# Autodesk Inventor assembly: MM0861AN105_G12_001
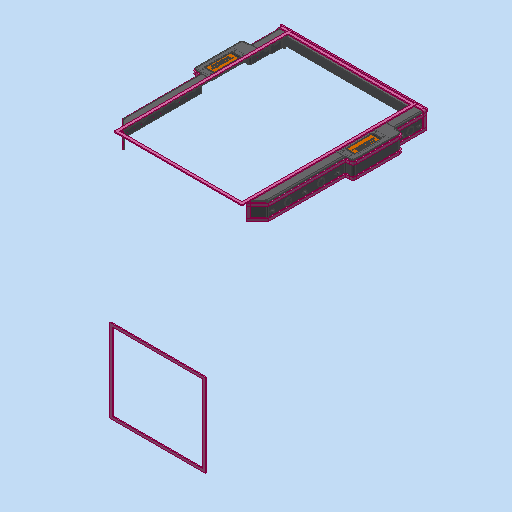
[picture p0: Inventor's stored thumbnail of the model, 512x512]
Saved by Autodesk Inventor 2023.3 (Build 273359000, 359)
## iProperties
Part Number: MM0861AN105_G12_001
Material: Generisch
Description: =<RBPARTNOTITLE2>
Document SubType Name: Assembly
Designer: ric7an
Mass: 4497.53 g
Surface Area: 6763.95 cm^2
Volume: 875.397 cm^3
Density: 5.1377 g/cm^3
RBCHANGEDESCRIPTION1: Erstfreigabe
RBCHANGENO1: 00
RBDOCUMENTTYPE: DRF
RBDOCUMENTVERSION: 00
RBDRAWINGMAINSCALE: 1:1
RBDRAWINGMISSINGSPEC: --
RBDRAWINGVOLUME: --
RBDSV1: 0850
RBGBDETAILS: 43274
RBGBEDGESIN1: +0,5
RBGBEDGESIN2: +0,2
RBGBEDGESOUT1: -0,3
RBGBEDGESOUT2: -0,1
RBMATERIAL: =<Material>
RBMATMEETS: --
RBMATNO: =<Part Number>
RBORGUNITRESPONSIBLE1: AnP/TEF1
RBPARTMADEOF: --
RBPARTNO: SIEHE MNR
RBPARTNOTITLE1: sealing single mineral cast
RBPARTNOTITLE2: Dichtung Mineralguss einfach
RBPARTSAFETYINDICATOR: --
RBSURFACE: --
RBSURFACE2: --
RBZEDGESNORM: ISO13715:2002-06
RBZGENDIMCLASS: m
RBZGENDIMNORM: ISO 2768-1:1989-11
RBZGENGEOCLASS: H
RBZGENGEONORM: ISO 2768-2:1989-11
RBZSURFACENORM: ISO13D2:2002-02
RBZTOLERANCENORM: ISO 14405-1:2010-12
AnP_Kommentar: --
MaxAbmaße: --
AnP_TemplVers: 20190222
AnP_Kategorie: 99
AnP_Material: =<Material>
Author: ric7an
Keywords: =<RBPARTMADEOF>
Comments: =<RBSURFACE2>
Revision Number: 01
## Documents named in this file (7)
- C:\Users\rea9an\Documents\Inventor\TCAI2412_te1910_EM\AS00000894.iam
- C:\Users\rea9an\Documents\Inventor\TCAI2412_te1910_EM\PT00004392.ipt
- C:\Users\rea9an\Documents\Inventor\TCAI2412_te1910_EM\AS00000893.iam
- C:\Users\rea9an\Documents\Inventor\TCAI2412_te1910_EM\PT00004438.ipt
- C:\Users\rea9an\Documents\Inventor\TCAI2412_te1910_EM\PT00004446.ipt
- C:\Users\rea9an\Documents\Inventor\TCAI2412_te1910_EM\AS00000895.iam
- C:\Users\rea9an\Documents\Inventor\TCAI2412_te1910_EM\AS00000896.iam
## Components (16 placed, 6 different names)
1. AS00000895:1 [sub-assembly] — Fluchtend:10, Fluchtend:13, Passend:21, Fluchtend:18, Passend:31, Passend:32, Passend:33, Passend:34, Passend:35, Passend:36, Passend:37, Passend:38, Passend:39, Passend:40, Passend:41, Passend:42, Passend:43, Passend:44, Passend:45, Passend:56, Einfügen:45, Passend:66
2. AS00000896:1 [sub-assembly] — Fluchtend:14, Passend:20, Fluchtend:18, Passend:46, Passend:47, Passend:48, Passend:49, Passend:50, Fluchtend:21, Passend:55, Einfügen:44, Passend:65
3. AS00000893:1 [sub-assembly]
4. PT00004438:1 — Fluchtend:21, Passend:55, Passend:56
5. PT00004446:1 — Einfügen:45, Passend:66
6. PT00004446:2 — Einfügen:44, Passend:65
7. PT00004392:10 — Passend:41, Passend:46
8. PT00004392:9 — Passend:42, Passend:47
9. PT00004392:8 — Passend:43, Passend:48
10. PT00004392:7 — Passend:44, Passend:49
11. PT00004392:6 — Passend:45, Passend:50
12. PT00004392:5 — Passend:32, Passend:37
13. PT00004392:4 — Passend:33, Passend:38
14. PT00004392:3 — Passend:34, Passend:39
15. PT00004392:2 — Passend:35, Passend:40
16. PT00004392:1 — Passend:31, Passend:36
## Relationships (53: Mate 39, Flush 12, Insert 2)
- [Mate]: AS00000895:1 ↔ AS00000893:1
- [Flush]: AS00000895:1 ↔ AS00000893:1
- [Mate]: AS00000895:1 ↔ AS00000893:1
- [Flush]: AS00000895:1 ↔ AS00000893:1
- [Flush]: AS00000895:1 ↔ AS00000893:1
- [Mate]: AS00000895:1 ↔ AS00000893:1
- Fluchtend:10 [Flush] (293 mm): AS00000895:1
- Fluchtend:13 [Flush] (-1074.5 mm): AS00000895:1
- Fluchtend:14 [Flush] (1074.5 mm): AS00000896:1
- Passend:20 [Mate] (-3.5 mm): AS00000896:1
- Passend:21 [Mate] (-3.5 mm): AS00000895:1
- [Mate]: AS00000896:1 ↔ AS00000893:1
- [Flush]: AS00000896:1 ↔ AS00000893:1
- [Flush]: AS00000896:1 ↔ AS00000893:1
- Fluchtend:18 [Flush] (-586 mm): AS00000895:1 ↔ AS00000896:1
- [Mate]: AS00000896:1 ↔ AS00000893:1
- Passend:31 [Mate]: AS00000895:1 ↔ PT00004392:1
- Passend:32 [Mate]: AS00000895:1 ↔ PT00004392:5
- Passend:33 [Mate]: AS00000895:1 ↔ PT00004392:4
- Passend:34 [Mate]: AS00000895:1 ↔ PT00004392:3
- Passend:35 [Mate]: AS00000895:1 ↔ PT00004392:2
- Passend:36 [Mate]: AS00000895:1 ↔ PT00004392:1
- Passend:37 [Mate]: AS00000895:1 ↔ PT00004392:5
- Passend:38 [Mate]: AS00000895:1 ↔ PT00004392:4
- Passend:39 [Mate]: AS00000895:1 ↔ PT00004392:3
- Passend:40 [Mate]: AS00000895:1 ↔ PT00004392:2
- Passend:41 [Mate]: AS00000895:1 ↔ PT00004392:10
- Passend:42 [Mate]: AS00000895:1 ↔ PT00004392:9
- Passend:43 [Mate]: AS00000895:1 ↔ PT00004392:8
- Passend:44 [Mate]: AS00000895:1 ↔ PT00004392:7
- Passend:45 [Mate]: AS00000895:1 ↔ PT00004392:6
- Passend:46 [Mate]: AS00000896:1 ↔ PT00004392:10
- Passend:47 [Mate]: AS00000896:1 ↔ PT00004392:9
- Passend:48 [Mate]: AS00000896:1 ↔ PT00004392:8
- Passend:49 [Mate]: AS00000896:1 ↔ PT00004392:7
- Passend:50 [Mate]: AS00000896:1 ↔ PT00004392:6
- [Mate]: AS00000895:1 ↔ AS00000893:1
- [Mate]: AS00000895:1 ↔ AS00000893:1
- [Flush]: AS00000895:1 ↔ AS00000893:1
- [Mate]: AS00000896:1 ↔ AS00000893:1
- [Mate]: AS00000896:1 ↔ AS00000893:1
- [Flush]: AS00000896:1 ↔ AS00000893:1
- Fluchtend:21 [Flush]: AS00000896:1 ↔ PT00004438:1
- Passend:55 [Mate] (2.5 mm): AS00000896:1 ↔ PT00004438:1
- Passend:56 [Mate] (-2.5 mm): AS00000895:1 ↔ PT00004438:1
- [Mate]: AS00000896:1 ↔ AS00000893:1
- [Mate]: AS00000896:1 ↔ AS00000893:1
- [Mate]: AS00000895:1 ↔ AS00000893:1
- [Mate]: AS00000895:1 ↔ AS00000893:1
- Einfügen:44 [Insert]: AS00000896:1 ↔ PT00004446:2
- Passend:65 [Mate]: AS00000896:1 ↔ PT00004446:2
- Einfügen:45 [Insert]: AS00000895:1 ↔ PT00004446:1
- Passend:66 [Mate]: AS00000895:1 ↔ PT00004446:1
